# Autodesk Inventor assembly: TRCR_V1
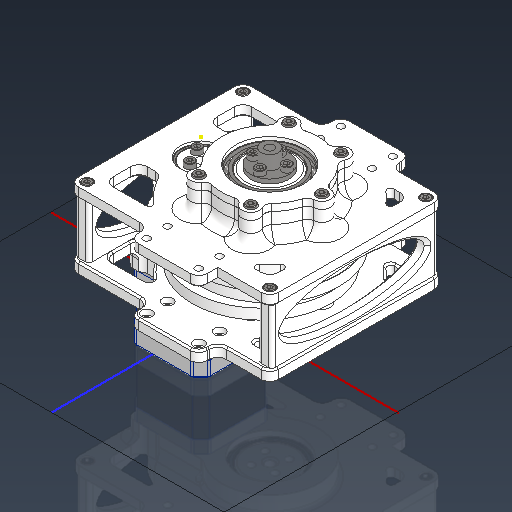
[picture p0: Inventor's stored thumbnail of the model, 512x512]
Saved by Autodesk Inventor 2026.2 (Build 302298010, 298A)
## iProperties
Created: 2026-04-09
Part Number: TRCR_V1
Document SubType Name: Assembly
Designer: khw
Mass: 1059.33 g
Surface Area: 1831.55 cm^2
Volume: 370.875 cm^3
Author: khw
## Documents named in this file (17)
- C:\Users\khw\Desktop\ARD_v1\ARD_hardware\TRCR_Project\TRCRv1\TRCR_V1.iam
- C:\Users\khw\Desktop\ARD_v1\ARD_hardware\TRCR_Project\TRCRv1\M3PIN.ipt
- C:\Users\khw\Desktop\ARD_v1\ARD_hardware\TRCR_Project\TRCRv1\OUTPUT.ipt
- C:\Users\khw\Desktop\ARD_v1\ARD_hardware\TRCR_Project\TRCRv1\shaft.ipt
- C:\Users\khw\Documents\Inventor\Content Center Files\R2026\ko-KR\ISO 15\ISO 15 - 7 17 - 20 x 27 x 4.ipt
- C:\Users\khw\Desktop\ARD_v1\ARD_hardware\TRCR_Project\TRCRv1\KS B 1003 - M 3 x 10.ipt
- C:\Users\khw\Desktop\ARD_v1\ARD_hardware\TRCR_Project\TRCRv1\JIS B 1521 - 6806 30x42x7x4.7.ipt
- C:\Users\khw\Desktop\ARD_v1\ARD_hardware\TRCR_Project\TRCRv1\dick_v3.ipt
- C:\Users\khw\Desktop\ARD_v1\ARD_hardware\TRCR_Project\TRCRv1\CASE.ipt
- C:\Users\khw\Desktop\ARD_v1\ARD_hardware\TRCR_Project\TRCRv1\CASE_T.ipt
- C:\Users\khw\Desktop\ARD_v1\ARD_hardware\TRCR_Project\TRCRv1\case_s.ipt
- C:\Users\khw\Desktop\ARD_v1\ARD_hardware\TRCR_Project\TRCRv1\KS B 1003 - M 3 x 6.ipt
- C:\Users\khw\Desktop\ARD_v1\ARD_hardware\ARD_Model_v1\5_Co.ipt
- C:\Users\khw\Documents\Inventor\Content Center Files\R2026\ko-KR\KS B 1003\KS B 1003 - M 3 x 30.ipt
- C:\Users\khw\Desktop\ARD_v1\ARD_hardware\TRCR_Project\TRCRv1\NEMA17.ipt
- C:\Users\khw\Desktop\ARD_v1\ARD_hardware\TRCR_Project\TRCRv1\KS B 1003 - M 3 x 25.ipt
- C:\Users\khw\Desktop\ARD_v1\ARD_hardware\TRCR_Project\TRCRv1\side.ipt
## Components (76 placed, 16 different names)
1. shaft:1 — 메이트:2, 메이트:3, 메이트:4, 플러쉬:2, 플러쉬:4, 메이트:20, 메이트:21, 플러쉬:6, 메이트:22, 플러쉬:7, 메이트:26, 메이트:27, 회전:7, 회전:8, 회전:9, 회전:1
2. OUTPUT:1 — 메이트:10, 메이트:11, 회전:1, 메이트:12, 메이트:13, 메이트:14, 메이트:15, 메이트:16, 메이트:31, 메이트:37, 메이트:38, 메이트:39
3. OUTPUT:2 — 메이트:14, 메이트:15, 메이트:16, 메이트:28, 플러쉬:8, 메이트:29, 메이트:30
4. dick_v3:1 — 메이트:19, 플러쉬:5, 메이트:20, 각도:1, 각도:2
5. dick_v3:2 — 메이트:18, 플러쉬:3, 플러쉬:4, 각도:2, 메이트:31
6. dick_v3:3 — 메이트:17, 플러쉬:1, 플러쉬:2, 각도:1
7. CASE:1 — 메이트:26, 메이트:27, 메이트:29, 메이트:30, 메이트:40, 각도:3, 메이트:41, 회전:10, 메이트:47, 회전:12, 회전:14, 회전:15, 회전:18
8. CASE_T:1 — 메이트:32, 메이트:33, 메이트:34, 메이트:35, 메이트:36, 메이트:45, 메이트:46, 메이트:48, 메이트:49, 메이트:50, 회전:11, 회전:13, 회전:16, 회전:17
9. case_s:1 — 메이트:34, 메이트:35, 메이트:36, 회전:2, 메이트:42
10. side:1 — 메이트:45, 메이트:46, 메이트:47
11. side:2 — 메이트:48, 메이트:49, 메이트:50
12. 5_Co:1 — 메이트:37, 메이트:38, 메이트:39, 회전:3, 회전:4, 회전:5, 회전:6, 회전:1
13. NEMA17:1 — 메이트:40, 각도:3, 메이트:41, 메이트:43, 메이트:44
14. KS B 1003 - M 3 x 6:12 — 회전:11
15. KS B 1003 - M 3 x 6:13 — 회전:12
16. KS B 1003 - M 3 x 6:14 — 회전:13
17. KS B 1003 - M 3 x 6:15 — 회전:14
18. KS B 1003 - M 3 x 6:16 — 회전:15
19. KS B 1003 - M 3 x 6:17 — 회전:16
20. KS B 1003 - M 3 x 6:18 — 회전:17
21. KS B 1003 - M 3 x 6:19 — 회전:18
22. KS B 1003 - 미터 M 3 x 30:1 — 회전:8
23. KS B 1003 - 미터 M 3 x 30:2 — 회전:9
24. KS B 1003 - 미터 M 3 x 30:3 — 회전:7
25. JIS B 1521 - 6806 30x42x7x4.7:2 — 메이트:28, 플러쉬:8
26. KS B 1003 - M 3 x 6:1 — 회전:3
27. KS B 1003 - M 3 x 6:2 — 회전:4
28. KS B 1003 - M 3 x 6:3 — 회전:5
29. KS B 1003 - M 3 x 6:5 — 회전:6
30. ISO 15 7 17 - 20 x 27 x 4:4 — 메이트:21, 플러쉬:6, 메이트:33
31. ISO 15 7 17 - 20 x 27 x 4:5 — 메이트:22, 플러쉬:7
32. JIS B 1521 - 6806 30x42x7x4.7:1 — 메이트:12, 메이트:13, 메이트:32, 메이트:42
33. ISO 15 7 17 - 20 x 27 x 4:1 — 메이트:2, 메이트:17, 플러쉬:1
34. ISO 15 7 17 - 20 x 27 x 4:2 — 메이트:3, 메이트:18, 플러쉬:3
35. ISO 15 7 17 - 20 x 27 x 4:3 — 메이트:4, 메이트:19, 플러쉬:5
36. KS B 1003 - M 3 x 25:1 — 회전:10
37. KS B 1003 - M 3 x 25:2
38. KS B 1003 - M 3 x 25:3
39. KS B 1003 - M 3 x 25:4
40. KS B 1003 - M 3 x 6:6 — 회전:2
41. KS B 1003 - M 3 x 6:7
42. KS B 1003 - M 3 x 6:9
43. KS B 1003 - M 3 x 6:10
44. KS B 1003 - M 3 x 6:11
45. M3PIN:1 — 메이트:10, 메이트:11
46. KS B 1003 - M 3 x 10:1 — 회전:1
47. M3PIN:2
48. KS B 1003 - M 3 x 10:2
49. M3PIN:3
50. KS B 1003 - M 3 x 10:3
51. M3PIN:4
52. KS B 1003 - M 3 x 10:4
53. M3PIN:5
54. KS B 1003 - M 3 x 10:5
55. M3PIN:6
56. KS B 1003 - M 3 x 10:6
57. M3PIN:7
58. KS B 1003 - M 3 x 10:7
59. M3PIN:8
60. KS B 1003 - M 3 x 10:8
61. M3PIN:9
62. KS B 1003 - M 3 x 10:9
63. M3PIN:10
64. KS B 1003 - M 3 x 10:10
65. M3PIN:11
66. KS B 1003 - M 3 x 10:11
67. M3PIN:12
68. KS B 1003 - M 3 x 10:12
69. M3PIN:13
70. KS B 1003 - M 3 x 10:13
71. M3PIN:14
72. KS B 1003 - M 3 x 10:14
73. M3PIN:15
74. KS B 1003 - M 3 x 10:15
75. M3PIN:16
76. KS B 1003 - M 3 x 10:16
## Component patterns: (4 elements, first: KS B 1003 - M 3 x 25:1), (6 elements, first: KS B 1003 - M 3 x 6:6), (16 elements, first: M3PIN:1 + KS B 1003 - M 3 x 10:1)
## Relationships (71: Mate 41, RevoluteJoint 18, Flush 8, Angle 3, RelateRotation 1)
- 메이트:2 [Mate]: shaft:1 ↔ ISO 15 7 17 - 20 x 27 x 4:1
- 메이트:3 [Mate]: shaft:1 ↔ ISO 15 7 17 - 20 x 27 x 4:2
- 메이트:4 [Mate]: shaft:1 ↔ ISO 15 7 17 - 20 x 27 x 4:3
- 메이트:10 [Mate]: OUTPUT:1 ↔ M3PIN:1
- 메이트:11 [Mate]: OUTPUT:1 ↔ M3PIN:1
- 회전:1 [RevoluteJoint]: OUTPUT:1 ↔ KS B 1003 - M 3 x 10:1
- 메이트:12 [Mate]: OUTPUT:1 ↔ JIS B 1521 - 6806 30x42x7x4.7:1
- 메이트:13 [Mate]: OUTPUT:1 ↔ JIS B 1521 - 6806 30x42x7x4.7:1
- 메이트:14 [Mate] (39 mm): OUTPUT:1 ↔ OUTPUT:2
- 메이트:15 [Mate]: OUTPUT:1 ↔ OUTPUT:2
- 메이트:16 [Mate]: OUTPUT:1 ↔ OUTPUT:2
- 메이트:17 [Mate]: dick_v3:3 ↔ ISO 15 7 17 - 20 x 27 x 4:1
- 플러쉬:1 [Flush]: dick_v3:3 ↔ ISO 15 7 17 - 20 x 27 x 4:1
- 플러쉬:2 [Flush] (-1 mm): shaft:1 ↔ dick_v3:3
- 메이트:18 [Mate]: dick_v3:2 ↔ ISO 15 7 17 - 20 x 27 x 4:2
- 플러쉬:3 [Flush]: dick_v3:2 ↔ ISO 15 7 17 - 20 x 27 x 4:2
- 플러쉬:4 [Flush] (-1 mm): shaft:1 ↔ dick_v3:2
- 메이트:19 [Mate]: dick_v3:1 ↔ ISO 15 7 17 - 20 x 27 x 4:3
- 플러쉬:5 [Flush]: dick_v3:1 ↔ ISO 15 7 17 - 20 x 27 x 4:3
- 메이트:20 [Mate] (1 mm): shaft:1 ↔ dick_v3:1
- 메이트:21 [Mate]: shaft:1 ↔ ISO 15 7 17 - 20 x 27 x 4:4
- 플러쉬:6 [Flush]: shaft:1 ↔ ISO 15 7 17 - 20 x 27 x 4:4
- 메이트:22 [Mate]: shaft:1 ↔ ISO 15 7 17 - 20 x 27 x 4:5
- 플러쉬:7 [Flush]: shaft:1 ↔ ISO 15 7 17 - 20 x 27 x 4:5
- 메이트:26 [Mate]: shaft:1 ↔ CASE:1
- 메이트:27 [Mate]: shaft:1 ↔ CASE:1
- 메이트:28 [Mate]: OUTPUT:2 ↔ JIS B 1521 - 6806 30x42x7x4.7:2
- 플러쉬:8 [Flush]: OUTPUT:2 ↔ JIS B 1521 - 6806 30x42x7x4.7:2
- 메이트:29 [Mate]: OUTPUT:2 ↔ CASE:1
- 메이트:30 [Mate]: OUTPUT:2 ↔ CASE:1
- 각도:1 [Angle] (0 deg): dick_v3:1 ↔ dick_v3:3
- 각도:2 [Angle] (0 deg): dick_v3:1 ↔ dick_v3:2
- 메이트:31 [Mate]: OUTPUT:1 ↔ dick_v3:2
- 메이트:32 [Mate]: CASE_T:1 ↔ JIS B 1521 - 6806 30x42x7x4.7:1
- 메이트:33 [Mate]: CASE_T:1 ↔ ISO 15 7 17 - 20 x 27 x 4:4
- 메이트:34 [Mate]: CASE_T:1 ↔ case_s:1
- 메이트:35 [Mate]: CASE_T:1 ↔ case_s:1
- 메이트:36 [Mate]: CASE_T:1 ↔ case_s:1
- 회전:2 [RevoluteJoint]: case_s:1 ↔ KS B 1003 - M 3 x 6:6
- 메이트:37 [Mate]: OUTPUT:1 ↔ 5_Co:1
- 메이트:38 [Mate]: OUTPUT:1 ↔ 5_Co:1
- 메이트:39 [Mate]: OUTPUT:1 ↔ 5_Co:1
- 회전:3 [RevoluteJoint]: 5_Co:1 ↔ KS B 1003 - M 3 x 6:1
- 회전:4 [RevoluteJoint]: 5_Co:1 ↔ KS B 1003 - M 3 x 6:2
- 회전:5 [RevoluteJoint]: 5_Co:1 ↔ KS B 1003 - M 3 x 6:3
- 회전:6 [RevoluteJoint]: 5_Co:1 ↔ KS B 1003 - M 3 x 6:5
- 회전:7 [RevoluteJoint]: shaft:1 ↔ KS B 1003 - 미터 M 3 x 30:3
- 회전:8 [RevoluteJoint]: shaft:1 ↔ KS B 1003 - 미터 M 3 x 30:1
- 회전:9 [RevoluteJoint]: shaft:1 ↔ KS B 1003 - 미터 M 3 x 30:2
- 메이트:40 [Mate]: CASE:1 ↔ NEMA17:1
- 각도:3 [Angle] (0 deg): CASE:1 ↔ NEMA17:1
- 메이트:41 [Mate]: CASE:1 ↔ NEMA17:1
- 회전:10 [RevoluteJoint]: CASE:1 ↔ KS B 1003 - M 3 x 25:1
- 회전:1 [RelateRotation] (15 ul): shaft:1 ↔ 5_Co:1
- 메이트:42 [Mate]: case_s:1 ↔ JIS B 1521 - 6806 30x42x7x4.7:1
- 메이트:43 [Mate]: NEMA17:1
- 메이트:44 [Mate]: NEMA17:1
- 메이트:45 [Mate]: CASE_T:1 ↔ side:1
- 메이트:46 [Mate]: CASE_T:1 ↔ side:1
- 메이트:47 [Mate]: CASE:1 ↔ side:1
- 메이트:48 [Mate]: CASE_T:1 ↔ side:2
- 메이트:49 [Mate]: CASE_T:1 ↔ side:2
- 메이트:50 [Mate]: CASE_T:1 ↔ side:2
- 회전:11 [RevoluteJoint]: CASE_T:1 ↔ KS B 1003 - M 3 x 6:12
- 회전:12 [RevoluteJoint]: CASE:1 ↔ KS B 1003 - M 3 x 6:13
- 회전:13 [RevoluteJoint]: CASE_T:1 ↔ KS B 1003 - M 3 x 6:14
- 회전:14 [RevoluteJoint]: CASE:1 ↔ KS B 1003 - M 3 x 6:15
- 회전:15 [RevoluteJoint]: CASE:1 ↔ KS B 1003 - M 3 x 6:16
- 회전:16 [RevoluteJoint]: CASE_T:1 ↔ KS B 1003 - M 3 x 6:17
- 회전:17 [RevoluteJoint]: CASE_T:1 ↔ KS B 1003 - M 3 x 6:18
- 회전:18 [RevoluteJoint]: CASE:1 ↔ KS B 1003 - M 3 x 6:19
